# Autodesk Inventor assembly: modern conttrol
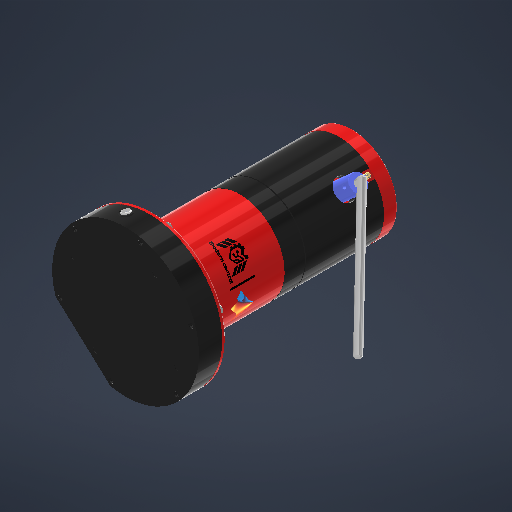
[picture p0: Inventor's stored thumbnail of the model, 512x512]
Saved by Autodesk Inventor 2027.1 (Build 311270010, 270A)
## iProperties
Created: 2026-10-15
Part Number: modern conttrol
Document SubType Name: Assembly
Designer: youss
Mass: 675.196 g
Surface Area: 2349.7 cm^2
Volume: 484.568 cm^3
Density: 1.3934 g/cm^3
Author: youss
## Documents named in this file (25)
- C:\Users\youss\Downloads\modern control\cad files\Workspaces\Workspace\modern conttrol.iam
- C:\Users\youss\Downloads\modern control model inventor\buck-converter-lm2596-output-5v-1.snapshot.7\LM2596_5V\LM2596_5V.ipt
- C:\Users\youss\Downloads\modern control model inventor\rotary-encoder-16.snapshot.5\Rotary Encoder\rotary encoder.ipt
- C:\Users\youss\Downloads\modern control model inventor\38-pin-esp32-wroom-esp-32d-development-kit-1.snapshot.3\ESP32 WROOM\ESP32 WROOM.ipt
- C:\Users\youss\Downloads\modern control model inventor\motor holder.ipt
- C:\Users\youss\OneDrive\Documents\Inventor\Content Center Files\R2027\en-US\ANSI AFBMA 21.1 NT(2)\ANSI_AFBMA 21.1 NT - 08NT01(1).ipt
- C:\Users\youss\OneDrive\Documents\Inventor\Content Center Files\R2027\en-US\ANSI AFBMA 21.1 NTW\ANSI_AFBMA 21.1 NTW - 08NTW12 8 x 21 x 0.8.ipt
- C:\Users\youss\Downloads\modern control\cad files\Workspaces\Workspace\Aluminum Alloy Flange Coupling, 4 mm SHAFT HO.ipt
- C:\Users\youss\Downloads\modern control model inventor\body.ipt
- C:\Users\youss\Downloads\modern control model inventor\part.ipt
- C:\Users\youss\Downloads\modern control model inventor\cover.ipt
- C:\Users\youss\Downloads\modern control model inventor\shaft.ipt
- C:\Users\youss\Downloads\modern control\cad files\Workspaces\Workspace\Rigid Coupling.ipt
- C:\Users\youss\Downloads\modern control\cad files\Workspaces\Workspace\motor_JGA25-370_EN_LR25.ipt
- C:\Users\youss\OneDrive\Documents\Inventor\Content Center Files\R2027\en-US\AS 1427(03)\AS 1427 - M2.5 x 10(1).ipt
- C:\Users\youss\Downloads\modern control model inventor\bracket for encoder.ipt
- C:\Users\youss\Downloads\modern control model inventor\threaded-insert-m3x5x4-1.snapshot.2\Threaded insert M3x5x4\Threaded insert M3x5x4.ipt
- C:\Users\youss\OneDrive\Documents\Inventor\Content Center Files\R2027\en-US\AS 1427(04)\AS 1427 - M3.5 x 16(5) I.ipt
- C:\Users\youss\OneDrive\Documents\Inventor\Content Center Files\R2027\en-US\AS 1427(04)\AS 1427 - M3 x 8(5) I.ipt
- C:\Users\youss\OneDrive\Documents\Inventor\Content Center Files\R2027\en-US\AS 1427(04)\AS 1427 - M3.5 x 20(5) I.ipt
- C:\Users\youss\Downloads\modern control model inventor\cover for electrical box.ipt
- C:\Users\youss\Downloads\tb6612fng-2.snapshot.1\Untitled\Untitled.ipt
- C:\Users\youss\Downloads\half-size-breadboard-1.snapshot.1 (1)\Half-Size Breadboard\STEP\Half-Size Breadboard\Half-Size Breadboard.ipt
- C:\Users\youss\Downloads\2-position-screw-down-terminal-block-to-female-dc-power-adapter-1.snapshot.16\Female DC-Power-to-Screw-Terminals-Adapter\Female DC-Power-to-Screw-Terminals-Adapter.ipt
- C:\Users\youss\OneDrive\Documents\Inventor\Content Center Files\R2027\en-US\AS 1427(04)\AS 1427 - M3.5 x 8(5) I.ipt
## Components (65 placed, 24 different names)
1. rotary encoder:1 — Mate:102, Mate:103, Mate:110, Mate:111, Mate:112, Mate:118
2. motor holder:1 — Mate:78, Mate:79, Mate:81, Mate:86, Mate:87, Mate:88, Mate:95, Mate:136, Mate:137, Mate:138, Mate:139, Mate:140, Mate:141, Mate:145
3. ANSI/AFBMA 21.1 NT - Thrust Needle Roller And Cage Assembly (Inch) 08NT01:1 — Tangent:1, Mate:20, Mate:21, Tangent:2, Mate:80
4. ANSI/AFBMA 21.1 NTW - Thrust Washer (Metric) 08NTW12 8 x 21 x 0.8:1 — Mate:21, Tangent:2, Mate:25
5. ANSI/AFBMA 21.1 NTW - Thrust Washer (Metric) 08NTW12 8 x 21 x 0.8:2 — Tangent:1, Mate:20, Mate:88
6. Aluminum Alloy Flange Coupling, 4 mm SHAFT HO:1 — Mate:25, Mate:55, Mate:57, Mate:131
7. part:1 — Mate:55, Mate:57, Mate:65, Mate:67, Mate:77, Mate:113, Mate:114, Mate:115, Mate:119, Flush:40, Mate:131, Mate:132, Mate:133, Mate:134, Mate:135, Mate:142
8. cover:1 — Mate:65, Mate:67, Mate:95, Mate:120, Mate:121, Mate:122, Mate:123, Mate:124, Mate:125, Mate:126
9. shaft:1 — Mate:117, Mate:118
10. Rigid Coupling:1 — Mate:102, Mate:103, Mate:117
11. motor_JGA25-370_EN_LR25:1 — Mate:77, Mate:78, Mate:79, Mate:80, Mate:81
12. AS 1427 - Metric M2.5 x 10:1 — Mate:86
13. AS 1427 - Metric M2.5 x 10:2 — Mate:87
14. bracket for encoder:1 — Mate:110, Mate:111, Mate:112, Mate:113, Mate:114, Mate:115, Mate:127, Mate:128, Mate:129, Mate:130
15. AS 1427 H - Metric M3.5 x 16:1 — Mate:121
16. AS 1427 H - Metric M3.5 x 16:2 — Mate:122
17. AS 1427 H - Metric M3.5 x 16:3 — Mate:123
18. AS 1427 H - Metric M3.5 x 16:4 — Mate:124
19. AS 1427 H - Metric M3.5 x 16:5 — Mate:125
20. AS 1427 H - Metric M3.5 x 16:6 — Mate:126
21. AS 1427 H - Metric M3.5 x 16:7 — Mate:127
22. AS 1427 H - Metric M3.5 x 16:8 — Mate:128
23. AS 1427 H - Metric M3.5 x 16:9 — Mate:129
24. AS 1427 H - Metric M3.5 x 16:10 — Mate:130
25. AS 1427 H - Metric M3 x 8:1 — Mate:132
26. AS 1427 H - Metric M3 x 8:2 — Mate:133
27. AS 1427 H - Metric M3 x 8:3 — Mate:134
28. AS 1427 H - Metric M3 x 8:4 — Mate:135
29. AS 1427 H - Metric M3.5 x 20:1 — Mate:136
30. AS 1427 H - Metric M3.5 x 20:2 — Mate:137
31. AS 1427 H - Metric M3.5 x 20:3 — Mate:138
32. AS 1427 H - Metric M3.5 x 20:4 — Mate:139, Mate:143
33. AS 1427 H - Metric M3.5 x 20:5 — Mate:140
34. AS 1427 H - Metric M3.5 x 20:6 — Mate:141
35. body:1 — Mate:142, Mate:143, Mate:144, Flush:41, Mate:145, Mate:165, Mate:166, Mate:172, Mate:173, Mate:174, Mate:175, Mate:176, Mate:177, Mate:178
36. cover for electrical box:1 — Flush:42, Mate:155, Mate:159, Flush:43, Mate:160, Mate:161, Mate:162, Mate:163, Mate:164, Flush:44, Flush:45, Flush:46, Flush:47, Flush:48, Mate:165, Mate:167, Mate:168, Mate:171, Angle:1, Mate:172
37. Threaded insert M3x5x4:13 — Flush:42, Mate:159, Flush:43, Mate:166
38. Untitled:1 — Mate:150, Mate:151, Mate:154
39. LM2596_5V:1 — Mate:169, Mate:170, Flush:49
40. ESP32 WROOM:1 — Mate:149, Mate:152, Mate:153, Mate:170, Flush:49
41. Half-Size Breadboard:1 — Mate:149, Mate:150, Mate:151, Mate:152, Mate:153, Mate:154, Mate:155, Mate:167, Mate:168, Mate:169
42. Threaded insert M3x5x4:14 — Mate:160, Flush:48
43. Threaded insert M3x5x4:15 — Mate:162, Flush:46
44. Threaded insert M3x5x4:16 — Mate:164, Flush:44
45. Threaded insert M3x5x4:17 — Mate:163, Flush:45
46. Threaded insert M3x5x4:18 — Mate:161, Flush:47
47. Female DC-Power-to-Screw-Terminals-Adapter:1 — Mate:171, Angle:1
48. AS 1427 H - Metric M3.5 x 8:1 — Mate:173
49. AS 1427 H - Metric M3.5 x 8:2 — Mate:174
50. AS 1427 H - Metric M3.5 x 8:3 — Mate:175
51. AS 1427 H - Metric M3.5 x 8:4 — Mate:176
52. AS 1427 H - Metric M3.5 x 8:5 — Mate:177
53. AS 1427 H - Metric M3.5 x 8:6 — Mate:178
54. Threaded insert M3x5x4:1 — Mate:119, Flush:40
55. Threaded insert M3x5x4:2
56. Threaded insert M3x5x4:3
57. Threaded insert M3x5x4:4
58. Threaded insert M3x5x4:5 — Mate:120
59. Threaded insert M3x5x4:6
60. Threaded insert M3x5x4:7 — Mate:144, Flush:41
61. Threaded insert M3x5x4:8
62. Threaded insert M3x5x4:9
63. Threaded insert M3x5x4:10
64. Threaded insert M3x5x4:11
65. Threaded insert M3x5x4:12
## Component patterns: (6 elements, first: Threaded insert M3x5x4:1), (6 elements, first: Threaded insert M3x5x4:7)
## Relationships (93: Mate 80, Flush 10, Tangent 2, Angle 1)
- Tangent:1: ANSI/AFBMA 21.1 NT - Thrust Needle Roller And Cage Assembly (Inch) 08NT01:1 ↔ ANSI/AFBMA 21.1 NTW - Thrust Washer (Metric) 08NTW12 8 x 21 x 0.8:2
- Mate:20: ANSI/AFBMA 21.1 NT - Thrust Needle Roller And Cage Assembly (Inch) 08NT01:1 ↔ ANSI/AFBMA 21.1 NTW - Thrust Washer (Metric) 08NTW12 8 x 21 x 0.8:2
- Mate:21: ANSI/AFBMA 21.1 NT - Thrust Needle Roller And Cage Assembly (Inch) 08NT01:1 ↔ ANSI/AFBMA 21.1 NTW - Thrust Washer (Metric) 08NTW12 8 x 21 x 0.8:1
- Tangent:2: ANSI/AFBMA 21.1 NT - Thrust Needle Roller And Cage Assembly (Inch) 08NT01:1 ↔ ANSI/AFBMA 21.1 NTW - Thrust Washer (Metric) 08NTW12 8 x 21 x 0.8:1
- Mate:25: ANSI/AFBMA 21.1 NTW - Thrust Washer (Metric) 08NTW12 8 x 21 x 0.8:1 ↔ Aluminum Alloy Flange Coupling, 4 mm SHAFT HO:1
- Mate:55: Aluminum Alloy Flange Coupling, 4 mm SHAFT HO:1 ↔ part:1
- Mate:57: Aluminum Alloy Flange Coupling, 4 mm SHAFT HO:1 ↔ part:1
- Mate:65: part:1 ↔ cover:1
- Mate:67: part:1 ↔ cover:1
- Mate:77: part:1 ↔ motor_JGA25-370_EN_LR25:1
- Mate:78: motor holder:1 ↔ motor_JGA25-370_EN_LR25:1
- Mate:79: motor holder:1 ↔ motor_JGA25-370_EN_LR25:1
- Mate:80: ANSI/AFBMA 21.1 NT - Thrust Needle Roller And Cage Assembly (Inch) 08NT01:1 ↔ motor_JGA25-370_EN_LR25:1
- Mate:81: motor holder:1 ↔ motor_JGA25-370_EN_LR25:1
- Mate:86: motor holder:1 ↔ AS 1427 - Metric M2.5 x 10:1
- Mate:87: motor holder:1 ↔ AS 1427 - Metric M2.5 x 10:2
- Mate:88: motor holder:1 ↔ ANSI/AFBMA 21.1 NTW - Thrust Washer (Metric) 08NTW12 8 x 21 x 0.8:2
- Mate:95: motor holder:1 ↔ cover:1
- Mate:102: rotary encoder:1 ↔ Rigid Coupling:1
- Mate:103 (4 mm): rotary encoder:1 ↔ Rigid Coupling:1
- Mate:110: rotary encoder:1 ↔ bracket for encoder:1
- Mate:111: rotary encoder:1 ↔ bracket for encoder:1
- Mate:112: rotary encoder:1 ↔ bracket for encoder:1
- Mate:113: part:1 ↔ bracket for encoder:1
- Mate:114: part:1 ↔ bracket for encoder:1
- Mate:115: part:1 ↔ bracket for encoder:1
- Mate:117: shaft:1 ↔ Rigid Coupling:1
- Mate:118: rotary encoder:1 ↔ shaft:1
- Mate:119: part:1 ↔ Threaded insert M3x5x4:1
- Flush:40: part:1 ↔ Threaded insert M3x5x4:1
- Mate:120: cover:1 ↔ Threaded insert M3x5x4:5
- Mate:121: cover:1 ↔ AS 1427 H - Metric M3.5 x 16:1
- Mate:122: cover:1 ↔ AS 1427 H - Metric M3.5 x 16:2
- Mate:123: cover:1 ↔ AS 1427 H - Metric M3.5 x 16:3
- Mate:124: cover:1 ↔ AS 1427 H - Metric M3.5 x 16:4
- Mate:125: cover:1 ↔ AS 1427 H - Metric M3.5 x 16:5
- Mate:126: cover:1 ↔ AS 1427 H - Metric M3.5 x 16:6
- Mate:127: bracket for encoder:1 ↔ AS 1427 H - Metric M3.5 x 16:7
- Mate:128: bracket for encoder:1 ↔ AS 1427 H - Metric M3.5 x 16:8
- Mate:129: bracket for encoder:1 ↔ AS 1427 H - Metric M3.5 x 16:9
- Mate:130: bracket for encoder:1 ↔ AS 1427 H - Metric M3.5 x 16:10
- Mate:131: Aluminum Alloy Flange Coupling, 4 mm SHAFT HO:1 ↔ part:1
- Mate:132: part:1 ↔ AS 1427 H - Metric M3 x 8:1
- Mate:133: part:1 ↔ AS 1427 H - Metric M3 x 8:2
- Mate:134: part:1 ↔ AS 1427 H - Metric M3 x 8:3
- Mate:135: part:1 ↔ AS 1427 H - Metric M3 x 8:4
- Mate:136: motor holder:1 ↔ AS 1427 H - Metric M3.5 x 20:1
- Mate:137: motor holder:1 ↔ AS 1427 H - Metric M3.5 x 20:2
- Mate:138: motor holder:1 ↔ AS 1427 H - Metric M3.5 x 20:3
- Mate:139: motor holder:1 ↔ AS 1427 H - Metric M3.5 x 20:4
- Mate:140: motor holder:1 ↔ AS 1427 H - Metric M3.5 x 20:5
- Mate:141: motor holder:1 ↔ AS 1427 H - Metric M3.5 x 20:6
- Mate:142: part:1 ↔ body:1
- Mate:143: AS 1427 H - Metric M3.5 x 20:4 ↔ body:1
- Mate:144: body:1 ↔ Threaded insert M3x5x4:7
- Flush:41: body:1 ↔ Threaded insert M3x5x4:7
- Mate:145: motor holder:1 ↔ body:1
- Flush:42: cover for electrical box:1 ↔ Threaded insert M3x5x4:13
- Mate:149: ESP32 WROOM:1 ↔ Half-Size Breadboard:1
- Mate:150: Untitled:1 ↔ Half-Size Breadboard:1
- Mate:151: Untitled:1 ↔ Half-Size Breadboard:1
- Mate:152: ESP32 WROOM:1 ↔ Half-Size Breadboard:1
- Mate:153: ESP32 WROOM:1 ↔ Half-Size Breadboard:1
- Mate:154: Untitled:1 ↔ Half-Size Breadboard:1
- Mate:155: cover for electrical box:1 ↔ Half-Size Breadboard:1
- Mate:159: cover for electrical box:1 ↔ Threaded insert M3x5x4:13
- Flush:43: cover for electrical box:1 ↔ Threaded insert M3x5x4:13
- Mate:160: cover for electrical box:1 ↔ Threaded insert M3x5x4:14
- Mate:161: cover for electrical box:1 ↔ Threaded insert M3x5x4:18
- Mate:162: cover for electrical box:1 ↔ Threaded insert M3x5x4:15
- Mate:163: cover for electrical box:1 ↔ Threaded insert M3x5x4:17
- Mate:164: cover for electrical box:1 ↔ Threaded insert M3x5x4:16
- Flush:44: cover for electrical box:1 ↔ Threaded insert M3x5x4:16
- Flush:45: cover for electrical box:1 ↔ Threaded insert M3x5x4:17
- Flush:46: cover for electrical box:1 ↔ Threaded insert M3x5x4:15
- Flush:47: cover for electrical box:1 ↔ Threaded insert M3x5x4:18
- Flush:48: cover for electrical box:1 ↔ Threaded insert M3x5x4:14
- Mate:165: body:1 ↔ cover for electrical box:1
- Mate:166: body:1 ↔ Threaded insert M3x5x4:13
- Mate:167: cover for electrical box:1 ↔ Half-Size Breadboard:1
- Mate:168: cover for electrical box:1 ↔ Half-Size Breadboard:1
- Mate:169: LM2596_5V:1 ↔ Half-Size Breadboard:1
- Mate:170: LM2596_5V:1 ↔ ESP32 WROOM:1
- Flush:49: LM2596_5V:1 ↔ ESP32 WROOM:1
- Mate:171: cover for electrical box:1 ↔ Female DC-Power-to-Screw-Terminals-Adapter:1
- Angle:1 (0 deg): cover for electrical box:1 ↔ Female DC-Power-to-Screw-Terminals-Adapter:1
- Mate:172: body:1 ↔ cover for electrical box:1
- Mate:173: body:1 ↔ AS 1427 H - Metric M3.5 x 8:1
- Mate:174: body:1 ↔ AS 1427 H - Metric M3.5 x 8:2
- Mate:175: body:1 ↔ AS 1427 H - Metric M3.5 x 8:3
- Mate:176: body:1 ↔ AS 1427 H - Metric M3.5 x 8:4
- Mate:177: body:1 ↔ AS 1427 H - Metric M3.5 x 8:5
- Mate:178: body:1 ↔ AS 1427 H - Metric M3.5 x 8:6
